# Autodesk Inventor assembly: Roda V3
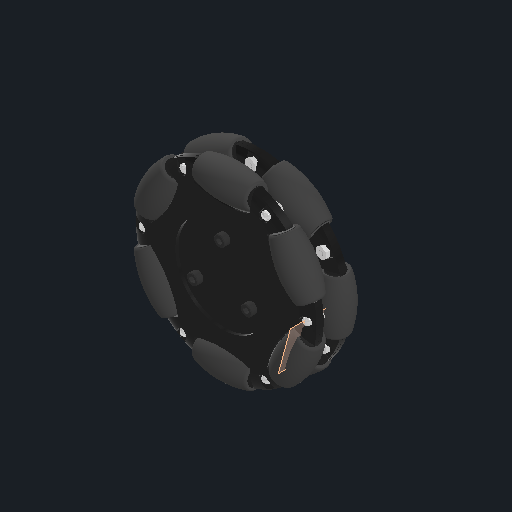
[picture p0: Inventor's stored thumbnail of the model, 512x512]
Saved by Autodesk Inventor 2026.1 (Build 301233000, 233)
## iProperties
Created: 2025-01-03
Part Number: Roda V3
Document SubType Name: Assembly
Designer: Cliente
Mass: 287.271 g
Surface Area: 1729.68 cm^2
Volume: 278.076 cm^3
Density: 1.03306 g/cm^3
Author: Cliente
## Documents named in this file (16)
- C:\Users\Cliente\Desktop\TCC\Base\Roda\Roda V3.iam
- C:\Users\Cliente\Desktop\TCC\Base\Roda\Espaçador roda.ipt
- C:\Users\Cliente\Desktop\TCC\Base\Roda\Tampa roda (porca - frente).ipt
- C:\Users\Cliente\Desktop\TCC\Base\Roda\Tampa roda (parafuso - frente).ipt
- C:\Users\Cliente\Desktop\TCC\Base\Roda\Tampa roda (porca - trás).ipt
- C:\Users\Cliente\Desktop\TCC\Base\Roda\Tampa roda (parafuso - trás).ipt
- C:\Users\Cliente\Desktop\TCC\Fixação\Porca 2,9mm.ipt
- C:\Users\Cliente\Desktop\TCC\Fixação\Parafuso 2,9 x 8mm.ipt
- C:\Users\Cliente\Desktop\TCC\Base\Roda\Acoplamento motor roda V2.ipt
- C:\Users\Cliente\Desktop\TCC\Base\Roda\Rolete V3.ipt
- C:\Users\Cliente\Desktop\TCC\Base\Roda\Eixo (rebite).ipt
- C:\Users\Cliente\Desktop\TCC\Fixação\Parafuso Allen Cabeça Cilíndrica DIN 912 - M4 - 12.9.ipt
- C:\Users\Cliente\Desktop\TCC\Fixação\Porca Sextavada DIN 934 - M4 - 8.ipt
- C:\Users\Cliente\Desktop\TCC\Fixação\Porca Sextavada DIN 934 - M3 - 8.ipt
- C:\Users\Cliente\Desktop\TCC\Fixação\Arruela Lisa DIN 125 - B3 - 300 HV.ipt
- C:\Users\Cliente\Desktop\TCC\Fixação\Parafuso Allen Cabeça Cilíndrica DIN 912 - M3 - 12.9.ipt
## Components (65 placed, 15 different names)
1. Espaçador roda:1 — Alinhado:1, Alinhado:2, Alinhado:3, Coincidente:1, Coincidente:2, Coincidente:3, Coincidente:10, Coincidente:11, Coincidente:12
2. Tampa roda (porca - frente):1 — Coincidente:1, Coincidente:2, Coincidente:3, Coincidente:7, Coincidente:8, Coincidente:9, Coincidente:25, Ângulo:2, Coincidente:34, Coincidente:35
3. Tampa roda (parafuso - frente):1 — Coincidente:7, Coincidente:8, Coincidente:9, Coincidente:19, Coincidente:26, Coincidente:29, Coincidente:30, Ângulo:4, Coincidente:39, Coincidente:42, Coincidente:43
4. Tampa roda (porca - trás):1 — Coincidente:10, Coincidente:11, Coincidente:12, Coincidente:16, Coincidente:17, Coincidente:18, Coincidente:20, Coincidente:23, Ângulo:1, Coincidente:41
5. Tampa roda (parafuso - trás):1 — Coincidente:16, Coincidente:17, Coincidente:18, Coincidente:24, Coincidente:27, Coincidente:28, Ângulo:3, Coincidente:31, Coincidente:32, Coincidente:33, Coincidente:36, Coincidente:37
6. Acoplamento motor roda V2:1 — Coincidente:31, Coincidente:32, Coincidente:33, Coincidente:45, Coincidente:46, Coincidente:47, Coincidente:48, Coincidente:49, Coincidente:51
7. Porca Sextavada DIN 934 - M3 - 8:1 — Coincidente:46, Ângulo:11, Coincidente:47
8. Arruela Lisa DIN 125 - B3 - 300 HV:1 — Coincidente:50, Coincidente:51, Alinhado:4, Coincidente:52, Coincidente:53
9. Arruela Lisa DIN 125 - B3 - 300 HV:2 — Coincidente:48, Coincidente:49, Ângulo:12, Coincidente:50, Alinhado:4, Alinhado:5
10. Arruela Lisa DIN 125 - B3 - 300 HV:3 — Coincidente:52, Coincidente:53, Alinhado:5, Coincidente:54, Coincidente:55
11. Parafuso Allen Cabeça Cilíndrica DIN 912 - M3 - 12.9:1 — Coincidente:54, Coincidente:55, Ângulo:13
12. Porca 2,9mm:1 — Coincidente:23, Coincidente:24, Ângulo:1
13. Parafuso 2,9 x 8mm:1 — Coincidente:27, Coincidente:28, Ângulo:3
14. Porca 2,9mm:3
15. Parafuso 2,9 x 8mm:3
16. Porca 2,9mm:4
17. Parafuso 2,9 x 8mm:4
18. Porca 2,9mm:5
19. Parafuso 2,9 x 8mm:5
20. Porca 2,9mm:6
21. Parafuso 2,9 x 8mm:6
22. Porca 2,9mm:7
23. Parafuso 2,9 x 8mm:7
24. Parafuso 2,9 x 8mm:2 — Coincidente:29, Coincidente:30, Ângulo:4
25. Porca 2,9mm:2 — Coincidente:25, Coincidente:26, Ângulo:2
26. Parafuso 2,9 x 8mm:8
27. Porca 2,9mm:8
28. Parafuso 2,9 x 8mm:9
29. Porca 2,9mm:9
30. Parafuso 2,9 x 8mm:10
31. Porca 2,9mm:10
32. Parafuso 2,9 x 8mm:11
33. Porca 2,9mm:11
34. Parafuso 2,9 x 8mm:12
35. Porca 2,9mm:12
36. Rolete V3:1 — Coincidente:38, Coincidente:39, Ângulo:7
37. Eixo (rebite):1 — Coincidente:34, Coincidente:35, Ângulo:5, Coincidente:38
38. Rolete V3:3
39. Eixo (rebite):3
40. Rolete V3:4
41. Eixo (rebite):4
42. Rolete V3:5
43. Eixo (rebite):5
44. Rolete V3:6
45. Eixo (rebite):6
46. Rolete V3:7
47. Eixo (rebite):7
48. Rolete V3:2 — Coincidente:40, Coincidente:41, Ângulo:8
49. Eixo (rebite):2 — Coincidente:36, Coincidente:37, Ângulo:6, Coincidente:40
50. Rolete V3:8
51. Eixo (rebite):8
52. Rolete V3:9
53. Eixo (rebite):9
54. Rolete V3:10
55. Eixo (rebite):10
56. Rolete V3:11
57. Eixo (rebite):11
58. Rolete V3:12
59. Eixo (rebite):12
60. Porca Sextavada DIN 934 - M4 - 8:1 — Coincidente:44, Ângulo:10, Coincidente:45
61. Parafuso Allen Cabeça Cilíndrica DIN 912 - M4 - 12.9:1 — Coincidente:42, Coincidente:43, Ângulo:9, Coincidente:44
62. Porca Sextavada DIN 934 - M4 - 8:2
63. Parafuso Allen Cabeça Cilíndrica DIN 912 - M4 - 12.9:2
64. Porca Sextavada DIN 934 - M4 - 8:3
65. Parafuso Allen Cabeça Cilíndrica DIN 912 - M4 - 12.9:3
## Component patterns: (6 elements, first: Porca 2,9mm:1 + Parafuso 2,9 x 8mm:1), (6 elements, first: Parafuso 2,9 x 8mm:2 + Porca 2,9mm:2), (6 elements, first: Rolete V3:1 + Eixo (rebite):1), (6 elements, first: Rolete V3:2 + Eixo (rebite):2), (3 elements, first: Porca Sextavada DIN 934 - M4 - 8:1 + Parafuso Allen Cabeça Cilíndrica DIN 912 - M4 - 12.9:1)
## Relationships (67: Mate 49, Angle 13, Flush 5)
- Alinhado:1 [Flush]: Espaçador roda:1
- Alinhado:2 [Flush]: Espaçador roda:1
- Alinhado:3 [Flush]: Espaçador roda:1
- Coincidente:1 [Mate]: Espaçador roda:1 ↔ Tampa roda (porca - frente):1
- Coincidente:2 [Mate]: Espaçador roda:1 ↔ Tampa roda (porca - frente):1
- Coincidente:3 [Mate]: Espaçador roda:1 ↔ Tampa roda (porca - frente):1
- Coincidente:7 [Mate]: Tampa roda (porca - frente):1 ↔ Tampa roda (parafuso - frente):1
- Coincidente:8 [Mate]: Tampa roda (porca - frente):1 ↔ Tampa roda (parafuso - frente):1
- Coincidente:9 [Mate]: Tampa roda (porca - frente):1 ↔ Tampa roda (parafuso - frente):1
- Coincidente:10 [Mate]: Espaçador roda:1 ↔ Tampa roda (porca - trás):1
- Coincidente:11 [Mate]: Espaçador roda:1 ↔ Tampa roda (porca - trás):1
- Coincidente:12 [Mate]: Espaçador roda:1 ↔ Tampa roda (porca - trás):1
- Coincidente:16 [Mate]: Tampa roda (porca - trás):1 ↔ Tampa roda (parafuso - trás):1
- Coincidente:17 [Mate]: Tampa roda (porca - trás):1 ↔ Tampa roda (parafuso - trás):1
- Coincidente:18 [Mate]: Tampa roda (porca - trás):1 ↔ Tampa roda (parafuso - trás):1
- Coincidente:19 [Mate]: Tampa roda (parafuso - frente):1
- Coincidente:20 [Mate]: Tampa roda (porca - trás):1
- Coincidente:21 [Mate]
- Coincidente:22 [Mate]
- Coincidente:23 [Mate]: Tampa roda (porca - trás):1 ↔ Porca 2,9mm:1
- Coincidente:24 [Mate]: Tampa roda (parafuso - trás):1 ↔ Porca 2,9mm:1
- Ângulo:1 [Angle] (0 deg): Tampa roda (porca - trás):1 ↔ Porca 2,9mm:1
- Coincidente:25 [Mate]: Tampa roda (porca - frente):1 ↔ Porca 2,9mm:2
- Coincidente:26 [Mate]: Tampa roda (parafuso - frente):1 ↔ Porca 2,9mm:2
- Ângulo:2 [Angle] (0 deg): Tampa roda (porca - frente):1 ↔ Porca 2,9mm:2
- Coincidente:27 [Mate]: Tampa roda (parafuso - trás):1 ↔ Parafuso 2,9 x 8mm:1
- Coincidente:28 [Mate]: Tampa roda (parafuso - trás):1 ↔ Parafuso 2,9 x 8mm:1
- Ângulo:3 [Angle] (90 deg): Tampa roda (parafuso - trás):1 ↔ Parafuso 2,9 x 8mm:1
- Coincidente:29 [Mate]: Tampa roda (parafuso - frente):1 ↔ Parafuso 2,9 x 8mm:2
- Coincidente:30 [Mate]: Tampa roda (parafuso - frente):1 ↔ Parafuso 2,9 x 8mm:2
- Ângulo:4 [Angle] (90 deg): Tampa roda (parafuso - frente):1 ↔ Parafuso 2,9 x 8mm:2
- Coincidente:31 [Mate]: Tampa roda (parafuso - trás):1 ↔ Acoplamento motor roda V2:1
- Coincidente:32 [Mate]: Tampa roda (parafuso - trás):1 ↔ Acoplamento motor roda V2:1
- Coincidente:33 [Mate]: Tampa roda (parafuso - trás):1 ↔ Acoplamento motor roda V2:1
- Coincidente:34 [Mate] (0.15 mm): Tampa roda (porca - frente):1 ↔ Eixo (rebite):1
- Coincidente:35 [Mate]: Tampa roda (porca - frente):1 ↔ Eixo (rebite):1
- Coincidente:36 [Mate] (0.15 mm): Tampa roda (parafuso - trás):1 ↔ Eixo (rebite):2
- Coincidente:37 [Mate]: Tampa roda (parafuso - trás):1 ↔ Eixo (rebite):2
- Ângulo:5 [Angle] (0 deg): Eixo (rebite):1
- Ângulo:6 [Angle] (180 deg): Eixo (rebite):2
- Coincidente:38 [Mate]: Rolete V3:1 ↔ Eixo (rebite):1
- Coincidente:39 [Mate] (0.5 mm): Tampa roda (parafuso - frente):1 ↔ Rolete V3:1
- Ângulo:7 [Angle] (0 deg): Rolete V3:1
- Coincidente:40 [Mate]: Rolete V3:2 ↔ Eixo (rebite):2
- Coincidente:41 [Mate] (0.5 mm): Tampa roda (porca - trás):1 ↔ Rolete V3:2
- Ângulo:8 [Angle] (180 deg): Rolete V3:2
- Coincidente:42 [Mate]: Tampa roda (parafuso - frente):1 ↔ Parafuso Allen Cabeça Cilíndrica DIN 912 - M4 - 12.9:1
- Coincidente:43 [Mate]: Tampa roda (parafuso - frente):1 ↔ Parafuso Allen Cabeça Cilíndrica DIN 912 - M4 - 12.9:1
- Ângulo:9 [Angle] (180 deg): Parafuso Allen Cabeça Cilíndrica DIN 912 - M4 - 12.9:1
- Coincidente:44 [Mate]: Porca Sextavada DIN 934 - M4 - 8:1 ↔ Parafuso Allen Cabeça Cilíndrica DIN 912 - M4 - 12.9:1
- Ângulo:10 [Angle] (0 deg): Porca Sextavada DIN 934 - M4 - 8:1
- Coincidente:45 [Mate]: Acoplamento motor roda V2:1 ↔ Porca Sextavada DIN 934 - M4 - 8:1
- Coincidente:46 [Mate]: Acoplamento motor roda V2:1 ↔ Porca Sextavada DIN 934 - M3 - 8:1
- Ângulo:11 [Angle] (0 deg): Porca Sextavada DIN 934 - M3 - 8:1
- Coincidente:47 [Mate]: Acoplamento motor roda V2:1 ↔ Porca Sextavada DIN 934 - M3 - 8:1
- Coincidente:48 [Mate] (2 mm): Acoplamento motor roda V2:1 ↔ Arruela Lisa DIN 125 - B3 - 300 HV:2
- Coincidente:49 [Mate]: Acoplamento motor roda V2:1 ↔ Arruela Lisa DIN 125 - B3 - 300 HV:2
- Ângulo:12 [Angle] (0 deg): Arruela Lisa DIN 125 - B3 - 300 HV:2
- Coincidente:50 [Mate]: Arruela Lisa DIN 125 - B3 - 300 HV:1 ↔ Arruela Lisa DIN 125 - B3 - 300 HV:2
- Coincidente:51 [Mate]: Acoplamento motor roda V2:1 ↔ Arruela Lisa DIN 125 - B3 - 300 HV:1
- Alinhado:4 [Flush]: Arruela Lisa DIN 125 - B3 - 300 HV:1 ↔ Arruela Lisa DIN 125 - B3 - 300 HV:2
- Coincidente:52 [Mate]: Arruela Lisa DIN 125 - B3 - 300 HV:1 ↔ Arruela Lisa DIN 125 - B3 - 300 HV:3
- Coincidente:53 [Mate]: Arruela Lisa DIN 125 - B3 - 300 HV:1 ↔ Arruela Lisa DIN 125 - B3 - 300 HV:3
- Alinhado:5 [Flush]: Arruela Lisa DIN 125 - B3 - 300 HV:2 ↔ Arruela Lisa DIN 125 - B3 - 300 HV:3
- Coincidente:54 [Mate]: Arruela Lisa DIN 125 - B3 - 300 HV:3 ↔ Parafuso Allen Cabeça Cilíndrica DIN 912 - M3 - 12.9:1
- Coincidente:55 [Mate]: Arruela Lisa DIN 125 - B3 - 300 HV:3 ↔ Parafuso Allen Cabeça Cilíndrica DIN 912 - M3 - 12.9:1
- Ângulo:13 [Angle] (0 deg): Parafuso Allen Cabeça Cilíndrica DIN 912 - M3 - 12.9:1
